# Autodesk Inventor assembly: new version
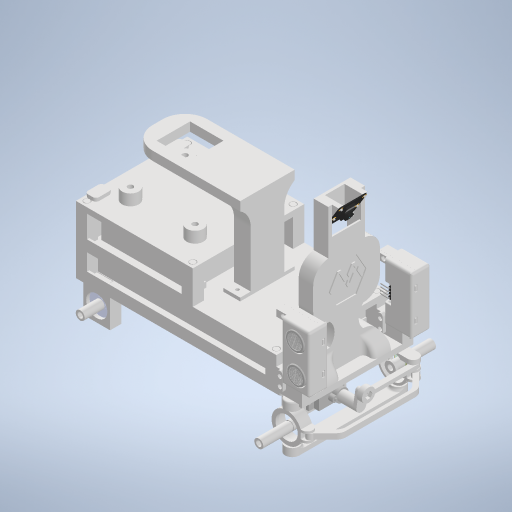
[picture p0: Inventor's stored thumbnail of the model, 512x512]
Saved by Autodesk Inventor 2023 (Build 270158000, 158)
## iProperties
Created: 2026-07-03
Part Number: new version
Document SubType Name: Assembly
Designer: Owner
Author: Owner
## Documents named in this file (10)
- C:\Users\Owner\OneDrive\Desktop\charbel\new version.iam
- C:\Users\Owner\Downloads\tire mounting - edited.ipt
- C:\Users\Owner\Downloads\Improved_cam (1).ipt
- C:\Users\Owner\Downloads\raspberrt-pi-noir-camera-module-8mp-imx219-rpi-cam-v2.iam
- C:\Users\Owner\OneDrive\Desktop\charbel\chassis new design.ipt
- C:\Users\Owner\Downloads\sg90-servo-motor-v1.iam
- C:\Users\Owner\Downloads\assembly.iam
- C:\Users\Owner\Downloads\ulltrasonic case assembled.iam
- C:\Users\Owner\Downloads\608-bearing-5.snapshot.3\Bearing_608.ipt
- C:\Users\Owner\Downloads\rear drive shaft.ipt
## Components (12 placed, 9 different names)
1. tire mounting - edited:1 — Mate:7, Flush:9, Flush:10, Mate:8, Mate:9
2. Improved_cam (1):1 — Mate:1, Mate:2, Mate:3, Mate:4, Mate:5, Mate:6, Flush:11
3. raspberrt-pi-noir-camera-module-8mp-imx219-rpi-cam-v2:1 [sub-assembly] — Mate:1, Mate:2, Mate:3
4. chassis new design:1 — Mate:4, Mate:5, Mate:6, Mate:7, Flush:9, Flush:10, Flush:11, Flush:12, Mate:10, Mate:11, Flush:13, Flush:14, Flush:15, Flush:16, Mate:12, Mate:13, Flush:17, Mate:14, Mate:15, Mate:16, Mate:17, Mate:18, Flush:18, Mate:20, Flush:19, Mate:22, Mate:24
5. sg90-servo-motor-v1:1 [sub-assembly] — Mate:8, Mate:9, Flush:12, Mate:10
6. assembly:1 [sub-assembly] — Mate:11, Flush:13, Flush:14, Flush:15, Flush:16, Mate:19, Mate:21, Mate:23
7. ulltrasonic case assembled:1 [sub-assembly] — Mate:13, Flush:17, Mate:14, Mate:15, Mate:16
8. ulltrasonic case assembled:2 [sub-assembly] — Mate:12, Mate:17, Mate:18
9. Bearing_608:1 — Mate:19, Flush:18
10. Bearing_608:2 — Mate:20, Flush:19
11. rear drive shaft:1 — Mate:21, Mate:22
12. rear drive shaft:2 — Mate:23, Mate:24
## Relationships (35: Mate 24, Flush 11)
- Mate:1: Improved_cam (1):1 ↔ raspberrt-pi-noir-camera-module-8mp-imx219-rpi-cam-v2:1
- Mate:2: Improved_cam (1):1 ↔ raspberrt-pi-noir-camera-module-8mp-imx219-rpi-cam-v2:1
- Mate:3 (0.5 mm): Improved_cam (1):1 ↔ raspberrt-pi-noir-camera-module-8mp-imx219-rpi-cam-v2:1
- Mate:4: Improved_cam (1):1 ↔ chassis new design:1
- Mate:5 (20 mm): Improved_cam (1):1 ↔ chassis new design:1
- Mate:6: Improved_cam (1):1 ↔ chassis new design:1
- Mate:7 (-2 mm): tire mounting - edited:1 ↔ chassis new design:1
- Flush:9 (5 mm): tire mounting - edited:1 ↔ chassis new design:1
- Flush:10 (-2.5 mm): tire mounting - edited:1 ↔ chassis new design:1
- Mate:8: tire mounting - edited:1 ↔ sg90-servo-motor-v1:1
- Flush:11 (-20 mm): Improved_cam (1):1 ↔ chassis new design:1
- Mate:9: tire mounting - edited:1 ↔ sg90-servo-motor-v1:1
- Flush:12: chassis new design:1 ↔ sg90-servo-motor-v1:1
- Mate:10: chassis new design:1 ↔ sg90-servo-motor-v1:1
- Mate:11 (5 mm): chassis new design:1 ↔ assembly:1
- Flush:13 (5 mm): chassis new design:1 ↔ assembly:1
- Flush:14 (-40.575 mm): chassis new design:1 ↔ assembly:1
- Flush:15 (0.4 mm): chassis new design:1 ↔ assembly:1
- Flush:16 (0.4 mm): chassis new design:1 ↔ assembly:1
- Mate:12: chassis new design:1 ↔ ulltrasonic case assembled:2
- Mate:13: chassis new design:1 ↔ ulltrasonic case assembled:1
- Flush:17: chassis new design:1 ↔ ulltrasonic case assembled:1
- Mate:14: chassis new design:1 ↔ ulltrasonic case assembled:1
- Mate:15: chassis new design:1 ↔ ulltrasonic case assembled:1
- Mate:16: chassis new design:1 ↔ ulltrasonic case assembled:1
- Mate:17: chassis new design:1 ↔ ulltrasonic case assembled:2
- Mate:18: chassis new design:1 ↔ ulltrasonic case assembled:2
- Mate:19: assembly:1 ↔ Bearing_608:1
- Flush:18 (5 mm): chassis new design:1 ↔ Bearing_608:1
- Mate:20: chassis new design:1 ↔ Bearing_608:2
- Flush:19: chassis new design:1 ↔ Bearing_608:2
- Mate:21: assembly:1 ↔ rear drive shaft:1
- Mate:22: chassis new design:1 ↔ rear drive shaft:1
- Mate:23: assembly:1 ↔ rear drive shaft:2
- Mate:24: chassis new design:1 ↔ rear drive shaft:2
